# Autodesk Inventor assembly: robotfish_new_1
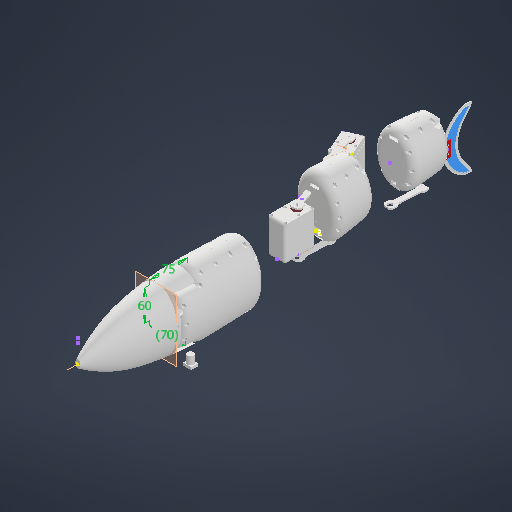
[picture p0: Inventor's stored thumbnail of the model, 512x512]
Saved by Autodesk Inventor 2027 (Build 310192060, 192F)
## iProperties
Created: 2026-08-25
Part Number: robotfish_new_1
Document SubType Name: Assembly
Designer: thita
Sending System: Autodesk Inventor 2027
Preprocessor: ST-DEVELOPER v20.1
Title: robotfish_newest_1.stp
Author: Laptop
## Documents named in this file (25)
- D:\Year2\đồ án tốt nghịp\đồ án tốt nghiệp v2\mới nhất v11\Workgroups\NotInProject\robotfish_newest_1.iam
- D:\Year2\đồ án tốt nghịp\đồ án tốt nghiệp v2\mới nhất v11\Workgroups\NotInProject\thanh lk.ipt
- D:\Year2\đồ án tốt nghịp\đồ án tốt nghiệp v2\mới nhất v11\Workgroups\NotInProject\thanh lk 1.ipt
- D:\Year2\đồ án tốt nghịp\đồ án tốt nghiệp v2\mới nhất v11\Workgroups\NotInProject\manh_tren_truc_2.ipt
- D:\Year2\đồ án tốt nghịp\đồ án tốt nghiệp v2\mới nhất v11\Workgroups\NotInProject\manh_tren_truc_3.ipt
- D:\Year2\đồ án tốt nghịp\đồ án tốt nghiệp v2\mới nhất v11\Workgroups\NotInProject\truc_khop_3_MIR.ipt
- D:\Year2\đồ án tốt nghịp\đồ án tốt nghiệp v2\mới nhất v11\Workgroups\NotInProject\hop v3.iam
- D:\Year2\đồ án tốt nghịp\đồ án tốt nghiệp v2\mới nhất v11\Workgroups\NotInProject\Assembly1.iam
- D:\Year2\đồ án tốt nghịp\đồ án tốt nghiệp v2\mới nhất v11\Workgroups\NotInProject\thanh lk 2.ipt
- D:\Year2\đồ án tốt nghịp\đồ án tốt nghiệp v2\mới nhất v11\Workgroups\NotInProject\thanh lk 4.ipt
- D:\Year2\đồ án tốt nghịp\đồ án tốt nghiệp v2\mới nhất v11\Workgroups\NotInProject\thanhlk 3.ipt
- D:\Year2\đồ án tốt nghịp\đồ án tốt nghiệp v2\mới nhất v11\Workgroups\NotInProject\thanhlk 5.ipt
- D:\Year2\đồ án tốt nghịp\đồ án tốt nghiệp v2\mới nhất v11\Workgroups\NotInProject\vây đuôi phương án A.ipt
- D:\Year2\đồ án tốt nghịp\đồ án tốt nghiệp v2\mới nhất v11\Workgroups\NotInProject\rigid_tailtail.ipt
- D:\Year2\đồ án tốt nghịp\đồ án tốt nghiệp v2\mới nhất v11\Workgroups\NotInProject\segment3.ipt
- D:\Year2\đồ án tốt nghịp\đồ án tốt nghiệp v2\mới nhất v11\Workgroups\NotInProject\seg1.ipt
- D:\Year2\đồ án tốt nghịp\đồ án tốt nghiệp v2\mới nhất v11\Workgroups\NotInProject\Pin 7.8Ah.ipt
- D:\Year2\đồ án tốt nghịp\đồ án tốt nghiệp v2\mới nhất v11\Workgroups\NotInProject\dau_robot.iam
- D:\Year2\đồ án tốt nghịp\đồ án tốt nghiệp v2\mới nhất v11\Workgroups\NotInProject\seg2 đã làm.ipt
- D:\Year2\đồ án tốt nghịp\đồ án tốt nghiệp v2\mới nhất v11\Workgroups\NotInProject\seg1_MIR.ipt
- seg1_TRAI.ipt
- D:\Year2\đồ án tốt nghịp\đồ án tốt nghiệp v2\mới nhất v11\Workgroups\NotInProject\seg2 đã làm_MIR1.ipt
- seg2 đã làm_TRAI.ipt
- D:\Year2\đồ án tốt nghịp\đồ án tốt nghiệp v2\mới nhất v11\Workgroups\NotInProject\segment3_MIR1.ipt
- segment3_TRAI.ipt
## Components (22 placed, 21 different names)
1. thanh lk:1 — Rigid:2, Rotational:8, Rigid:16
2. thanh lk 1:1 — Rotational:5, Rigid:4
3. manh_tren_truc_2:1 — Rigid:10, Rigid:21
4. manh_tren_truc_3:1 — Rigid:10, Rigid:17
5. hop v3:13 [sub-assembly] — Rigid:2, Rotational:5, Rigid:16
6. hop v3:14 [sub-assembly] — Rigid:4, Rotational:10
7. Assembly1:17 [sub-assembly] — Rotational:8
8. thanh lk 2:1 — Rotational:10, Rigid:11
9. thanh lk 4:2
10. thanhlk 3:2
11. thanhlk 5:2
12. vây đuôi phương án A:2
13. rigid_tailtail:3 — Rigid:11
14. segment3:4 — Flush:4
15. seg1:1 — Flush:1, Rigid:21, Rigid:22
16. truc_khop_3_MIR:2
17. Pin 7.8Ah:1 — Rigid:22
18. dau_robot:1 [sub-assembly] — Rigid:17, Mate:2
19. seg2 đã làm:2 — Flush:2, Flush:3
20. seg1_TRAI:1 — Mate:3
21. seg2 đã làm_TRAI:1 — Mate:4, Mate:5
22. segment3_TRAI:1 — Mate:6
## Relationships (20: WeldJoint 8, Mate 5, Flush 4, RevoluteJoint 3)
- Rigid:2 [WeldJoint]: thanh lk:1 ↔ hop v3:13
- Rotational:5 [RevoluteJoint]: thanh lk 1:1 ↔ hop v3:13
- Rigid:4 [WeldJoint]: thanh lk 1:1 ↔ hop v3:14
- Rotational:8 [RevoluteJoint]: thanh lk:1 ↔ Assembly1:17
- Rigid:10 [WeldJoint]: manh_tren_truc_2:1 ↔ manh_tren_truc_3:1
- Rotational:10 [RevoluteJoint]: hop v3:14 ↔ thanh lk 2:1
- Rigid:11 [WeldJoint]: thanh lk 2:1 ↔ rigid_tailtail:3
- Rigid:16 [WeldJoint]: thanh lk:1 ↔ hop v3:13
- Rigid:17 [WeldJoint]: manh_tren_truc_3:1 ↔ dau_robot:1
- Flush:1: seg1:1
- Mate:2: dau_robot:1
- Rigid:21 [WeldJoint]: manh_tren_truc_2:1 ↔ seg1:1
- Rigid:22 [WeldJoint]: seg1:1 ↔ Pin 7.8Ah:1
- Mate:3: seg1_TRAI:1
- Flush:2: seg2 đã làm:2
- Flush:3: seg2 đã làm:2
- Mate:4: seg2 đã làm_TRAI:1
- Mate:5: seg2 đã làm_TRAI:1
- Flush:4: segment3:4
- Mate:6: segment3_TRAI:1
## Named parameters: Finish1_Area = 24.1011
note: some values were not read from the file. Shown as the stored number, unit unknown: "Finish1_Area".
